# Autodesk Inventor assembly: 2204_260kv-motor
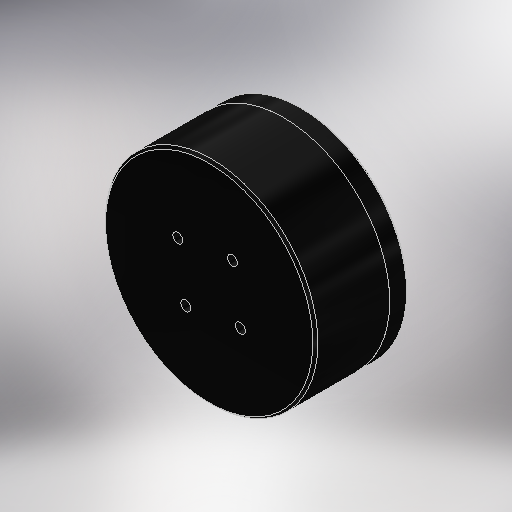
[picture p0: Inventor's stored thumbnail of the model, 512x512]
Saved by Autodesk Inventor 2025.3 (Build 293356030, 356C)
## iProperties
Created: 2026-05-04
Part Number: 2204_260kv-motor
Document SubType Name: Assembly
Designer: ibuki_ono
Author: ibuki_ono
## Documents named in this file (3)
- C:\Users\ibuki_ono\Documents\hobby\rogiken\catchrobo\2026_CAD\Hardware_2026\Inventor\End-Effector\2204_260kv-motor.iam
- C:\Users\ibuki_ono\Documents\hobby\rogiken\catchrobo\2026_CAD\Hardware_2026\Inventor\End-Effector\2204_260kv.ipt
- C:\Users\ibuki_ono\Documents\hobby\rogiken\catchrobo\2026_CAD\Hardware_2026\Inventor\End-Effector\2204_260kv-base.ipt
## Components (2 placed, 2 different names)
1. 2204_260kv:1 — メイト:1, メイト:2, メイト:4
2. 2204_260kv-base:1 — メイト:1, メイト:2, メイト:3
## Relationships (4: Mate 4)
- メイト:1 [Mate]: 2204_260kv:1 ↔ 2204_260kv-base:1
- メイト:2 [Mate]: 2204_260kv:1 ↔ 2204_260kv-base:1
- メイト:3 [Mate]: 2204_260kv-base:1
- メイト:4 [Mate]: 2204_260kv:1
